# Autodesk Inventor assembly: PowerBox
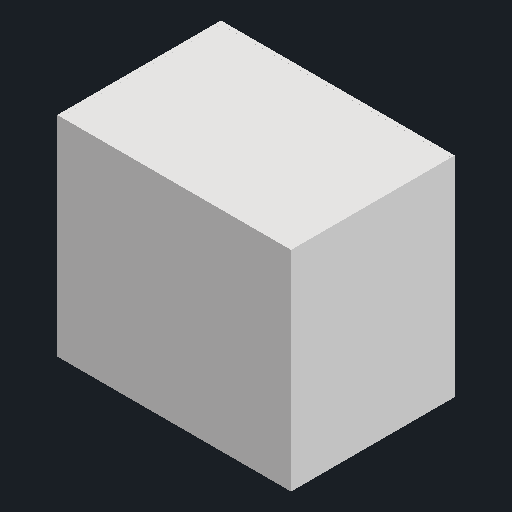
[picture p0: Inventor's stored thumbnail of the model, 512x512]
Saved by Autodesk Inventor 2027.1 (Build 311270010, 270A)
## iProperties
Created: 2026-10-13
Part Number: PowerBox
Document SubType Name: Assembly
Designer: SDS Scholar
Author: SDS Scholar
## Documents named in this file (4)
- E:\Apps\AutodeskInventor\University\MCT333_Design_of_Mechatronics_Systems_1\CAD\boxes\pneumatic_box\PneumaticBox.iam
- E:\Apps\AutodeskInventor\University\MCT333_Design_of_Mechatronics_Systems_1\CAD\boxes\pneumatic_box\PneumaticBoxLengthFace.ipt
- E:\Apps\AutodeskInventor\University\MCT333_Design_of_Mechatronics_Systems_1\CAD\boxes\pneumatic_box\PneumaticBoxWidthFace.ipt
- E:\Apps\AutodeskInventor\University\MCT333_Design_of_Mechatronics_Systems_1\CAD\boxes\pneumatic_box\PneumaticBoxCeiling.ipt
## Components (5 placed, 3 different names)
1. PneumaticBoxLengthFace:1 — Flush:1, Mate:1, Flush:2, Flush:3, Flush:4, Flush:5, Flush:6, Flush:7, Flush:9, Flush:10, Flush:11
2. PneumaticBoxLengthFace:2 — Flush:4, Flush:8, Flush:12, Flush:14
3. PneumaticBoxWidthFace:1 — Flush:3, Flush:9, Flush:11
4. PneumaticBoxWidthFace:2 — Flush:5, Flush:7, Flush:8, Flush:10, Flush:12, Flush:13
5. PneumaticBoxCeiling:1 — Flush:6, Flush:13, Flush:14
## Relationships (15: Flush 14, Mate 1)
- Flush:1: PneumaticBoxLengthFace:1
- Mate:1: PneumaticBoxLengthFace:1
- Flush:2: PneumaticBoxLengthFace:1
- Flush:3: PneumaticBoxLengthFace:1 ↔ PneumaticBoxWidthFace:1
- Flush:4: PneumaticBoxLengthFace:1 ↔ PneumaticBoxLengthFace:2
- Flush:5: PneumaticBoxLengthFace:1 ↔ PneumaticBoxWidthFace:2
- Flush:6: PneumaticBoxLengthFace:1 ↔ PneumaticBoxCeiling:1
- Flush:7: PneumaticBoxLengthFace:1 ↔ PneumaticBoxWidthFace:2
- Flush:8: PneumaticBoxLengthFace:2 ↔ PneumaticBoxWidthFace:2
- Flush:9: PneumaticBoxLengthFace:1 ↔ PneumaticBoxWidthFace:1
- Flush:10: PneumaticBoxLengthFace:1 ↔ PneumaticBoxWidthFace:2
- Flush:11: PneumaticBoxLengthFace:1 ↔ PneumaticBoxWidthFace:1
- Flush:12: PneumaticBoxLengthFace:2 ↔ PneumaticBoxWidthFace:2
- Flush:13: PneumaticBoxWidthFace:2 ↔ PneumaticBoxCeiling:1
- Flush:14: PneumaticBoxLengthFace:2 ↔ PneumaticBoxCeiling:1
